# Autodesk Inventor assembly: PC_stand
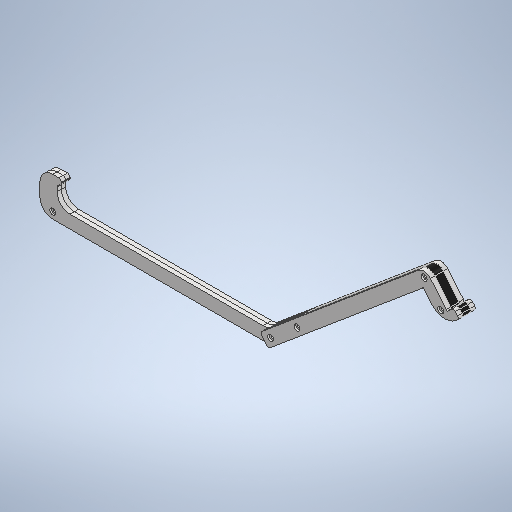
[picture p0: Inventor's stored thumbnail of the model, 512x512]
Saved by Autodesk Inventor 2025.3 (Build 293356030, 356C)
## iProperties
Created: 2025-08-02
Part Number: PC_stand
Document SubType Name: Assembly
Designer: ibuki_ono
Author: ibuki_ono
## Documents named in this file (6)
- C:\Users\ibuki_ono\Documents\hobby\rogiken\catchrobo\CAD\Hardware_CAD\Inventor\base\PC_stand.iam
- C:\Users\ibuki_ono\Documents\hobby\rogiken\catchrobo\CAD\Hardware_CAD\Inventor\base\AP5.0_PC-stand1.ipt
- C:\Users\ibuki_ono\Documents\hobby\rogiken\catchrobo\CAD\Hardware_CAD\Inventor\base\AP5.0_PC-stand2.ipt
- C:\Users\ibuki_ono\Documents\hobby\rogiken\catchrobo\CAD\Hardware_CAD\Inventor\base\AP5.0_PC-stand3.ipt
- C:\Users\ibuki_ono\Documents\hobby\rogiken\catchrobo\CAD\Hardware_CAD\Inventor\base\AP5.0_PC-stand4.ipt
- C:\Users\ibuki_ono\Documents\hobby\rogiken\catchrobo\CAD\Hardware_CAD\Inventor\base\AP5.0_PC-stand-spacer.ipt
## Components (5 placed, 5 different names)
1. AP5.0_PC-stand1:1 — 挿入:1, 挿入:2, 挿入:5, 挿入:6
2. AP5.0_PC-stand2:1 — 挿入:1, 挿入:2, 挿入:3, 挿入:4
3. AP5.0_PC-stand3:1 — 挿入:3, 挿入:4, 挿入:7, 挿入:8
4. AP5.0_PC-stand4:1 — 挿入:5, 挿入:6
5. AP5.0_PC-stand-spacer:1 — 挿入:7, 挿入:8
## Relationships (8: Insert 8)
- 挿入:1 [Insert]: AP5.0_PC-stand1:1 ↔ AP5.0_PC-stand2:1
- 挿入:2 [Insert]: AP5.0_PC-stand1:1 ↔ AP5.0_PC-stand2:1
- 挿入:3 [Insert]: AP5.0_PC-stand2:1 ↔ AP5.0_PC-stand3:1
- 挿入:4 [Insert]: AP5.0_PC-stand2:1 ↔ AP5.0_PC-stand3:1
- 挿入:5 [Insert]: AP5.0_PC-stand1:1 ↔ AP5.0_PC-stand4:1
- 挿入:6 [Insert]: AP5.0_PC-stand1:1 ↔ AP5.0_PC-stand4:1
- 挿入:7 [Insert]: AP5.0_PC-stand3:1 ↔ AP5.0_PC-stand-spacer:1
- 挿入:8 [Insert]: AP5.0_PC-stand3:1 ↔ AP5.0_PC-stand-spacer:1
